# Autodesk Inventor assembly: 传动1
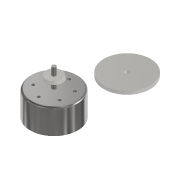
[picture p0: Inventor's stored thumbnail of the model, 180x180]
Saved by Autodesk Inventor 2021 (Build 250183000, 183)
## iProperties
Created: 2024-05-13
Part Number: 传动1
Document SubType Name: Assembly
Designer: teacher
Author: teacher
## Documents named in this file (4)
- C:\Users\teacher\Desktop\月球车模型-姓名\传动1.iam
- C:\Users\teacher\Desktop\月球车模型-姓名\300电机.ipt
- C:\Users\teacher\Desktop\月球车模型-姓名\皮带轮.ipt
- C:\Users\teacher\Desktop\月球车模型-姓名\皮带轮2.ipt
## Components (3 placed, 3 different names)
1. 300电机:1 — 圆柱:1
2. 皮带轮2:1 — 圆柱:1, 表面齐平:1
3. 皮带轮1:1 — 表面齐平:1
## Relationships (2: CylindricalJoint 1, Flush 1)
- 圆柱:1 [CylindricalJoint]: 300电机:1 ↔ 皮带轮2:1
- 表面齐平:1 [Flush]: 皮带轮2:1 ↔ 皮带轮1:1
